# Autodesk Inventor assembly: BG_Topfkern
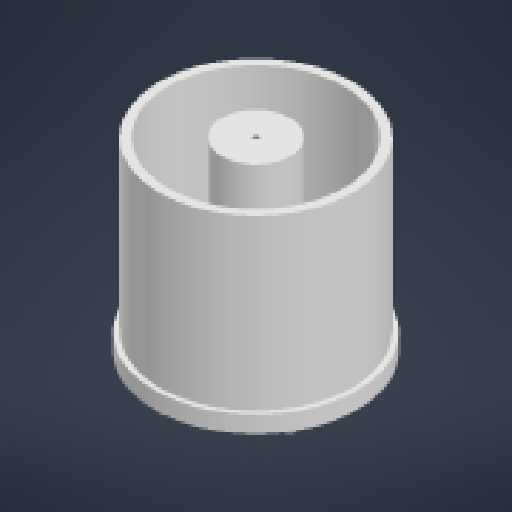
[picture p0: Inventor's stored thumbnail of the model, 512x512]
Saved by Autodesk Inventor 2027.1 (Build 311270010, 270A)
## iProperties
Created: 2026-10-16
Part Number: BG_Topfkern
Document SubType Name: Assembly
Designer: nicol
Author: nicol
## Documents named in this file (8)
- C:\Worksspace2\PA_2026\Electromagnetic_Levitation_System_git\Electromagnetic_Levitation_System\04_3D_Design\Topfkern\BG_Topfkern.iam
- C:\Worksspace2\PA_2026\Electromagnetic_Levitation_System_git\Electromagnetic_Levitation_System\04_3D_Design\Topfkern\Rückwand.ipt
- C:\Worksspace2\PA_2026\Electromagnetic_Levitation_System_git\Electromagnetic_Levitation_System\04_3D_Design\Topfkern\Mittelpol.ipt
- C:\Worksspace2\PA_2026\Electromagnetic_Levitation_System_git\Electromagnetic_Levitation_System\04_3D_Design\Topfkern\Mantel.ipt
- C:\Users\nicol\OneDrive\Dokumente\Inventor\Content Center Files\R2027\en-US\BS 4168(1)\BS 4168 - M10 x 30(1).ipt
- C:\Users\nicol\OneDrive\Dokumente\Inventor\Content Center Files\R2027\en-US\ISO 7089\ISO 7089 - 10 - 140 HV(1).ipt
- C:\Users\nicol\OneDrive\Dokumente\Inventor\Content Center Files\R2027\en-US\ISO 4762(2)\ISO 4762 - M3 x 20ISO.ipt
- C:\Users\nicol\OneDrive\Dokumente\Inventor\Content Center Files\R2027\en-US\ISO 7089\ISO 7089 - 3 - 140 HV(1).ipt
## Components (17 placed, 7 different names)
1. Rückwand:1 — Mate:1, Mate:2, Mate:3, Mate:4, Mate:5, Mate:6, Mate:7, Mate:9, Mate:10, Mate:11, Mate:12, Mate:13, Mate:14, Mate:15, Mate:16, Mate:17, Mate:18, Mate:19, Mate:20, Mate:21, Mate:25, Mate:27
2. Mittelpol:1 — Mate:1, Mate:2
3. Mantel:1 — Mate:3, Mate:4, Mate:5
4. BS 4168 : Part 1 Hexagon Socket Head Cap Screw - Metric M10 x 30:1 — Mate:8, Mate:9
5. ISO 7089 10:1 — Mate:6, Mate:7, Mate:8
6. ISO 4762 M3 x 20:1 — Mate:26, Mate:27
7. ISO 4762 M3 x 20:2 — Mate:32, Mate:33
8. ISO 4762 M3 x 20:3 — Mate:28, Mate:29
9. ISO 4762 M3 x 20:4 — Mate:30, Mate:31
10. ISO 4762 M3 x 20:5 — Mate:22, Mate:23
11. ISO 4762 M3 x 20:6 — Mate:24, Mate:25
12. ISO 7089 3:1 — Mate:18, Mate:19, Mate:32, Mate:33
13. ISO 7089 3:2 — Mate:20, Mate:21, Mate:28, Mate:29
14. ISO 7089 3:3 — Mate:12, Mate:13, Mate:30, Mate:31
15. ISO 7089 3:4 — Mate:10, Mate:11, Mate:26
16. ISO 7089 3:5 — Mate:14, Mate:15, Mate:24
17. ISO 7089 3:6 — Mate:16, Mate:17, Mate:22, Mate:23
## Relationships (33: Mate 33)
- Mate:1: Rückwand:1 ↔ Mittelpol:1
- Mate:2: Rückwand:1 ↔ Mittelpol:1
- Mate:3: Rückwand:1 ↔ Mantel:1
- Mate:4: Rückwand:1 ↔ Mantel:1
- Mate:5: Rückwand:1 ↔ Mantel:1
- Mate:6: Rückwand:1 ↔ ISO 7089 10:1
- Mate:7: Rückwand:1 ↔ ISO 7089 10:1
- Mate:8: BS 4168 : Part 1 Hexagon Socket Head Cap Screw - Metric M10 x 30:1 ↔ ISO 7089 10:1
- Mate:9: Rückwand:1 ↔ BS 4168 : Part 1 Hexagon Socket Head Cap Screw - Metric M10 x 30:1
- Mate:10: Rückwand:1 ↔ ISO 7089 3:4
- Mate:11: Rückwand:1 ↔ ISO 7089 3:4
- Mate:12: Rückwand:1 ↔ ISO 7089 3:3
- Mate:13: Rückwand:1 ↔ ISO 7089 3:3
- Mate:14: Rückwand:1 ↔ ISO 7089 3:5
- Mate:15: Rückwand:1 ↔ ISO 7089 3:5
- Mate:16: Rückwand:1 ↔ ISO 7089 3:6
- Mate:17: Rückwand:1 ↔ ISO 7089 3:6
- Mate:18: Rückwand:1 ↔ ISO 7089 3:1
- Mate:19: Rückwand:1 ↔ ISO 7089 3:1
- Mate:20: Rückwand:1 ↔ ISO 7089 3:2
- Mate:21: Rückwand:1 ↔ ISO 7089 3:2
- Mate:22: ISO 4762 M3 x 20:5 ↔ ISO 7089 3:6
- Mate:23: ISO 4762 M3 x 20:5 ↔ ISO 7089 3:6
- Mate:24: ISO 4762 M3 x 20:6 ↔ ISO 7089 3:5
- Mate:25: Rückwand:1 ↔ ISO 4762 M3 x 20:6
- Mate:26: ISO 4762 M3 x 20:1 ↔ ISO 7089 3:4
- Mate:27: Rückwand:1 ↔ ISO 4762 M3 x 20:1
- Mate:28: ISO 4762 M3 x 20:3 ↔ ISO 7089 3:2
- Mate:29: ISO 4762 M3 x 20:3 ↔ ISO 7089 3:2
- Mate:30: ISO 4762 M3 x 20:4 ↔ ISO 7089 3:3
- Mate:31: ISO 4762 M3 x 20:4 ↔ ISO 7089 3:3
- Mate:32: ISO 4762 M3 x 20:2 ↔ ISO 7089 3:1
- Mate:33: ISO 4762 M3 x 20:2 ↔ ISO 7089 3:1
